# Autodesk Inventor assembly: result-flush
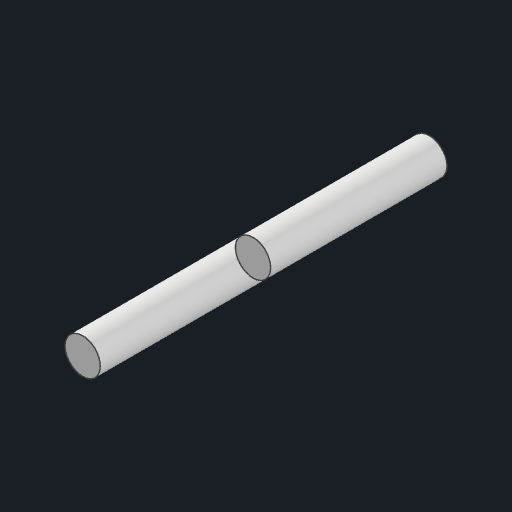
[picture p0: Inventor's stored thumbnail of the model, 512x512]
Saved by Autodesk Inventor 2026.1 (Build 301233000, 233)
## iProperties
Created: 2026-10-30
Part Number: result-flush
Document SubType Name: Assembly
Designer: david
Author: anony
## Documents named in this file (2)
- C:\Users\anony\OneDrive\Desktop\AI Projects\CAD Convert\corpus\generated\asmimate\result-flush.iam
- C:\Users\anony\OneDrive\Desktop\AI Projects\CAD Convert\corpus\generated\imate\flush.ipt
## Components (2 placed, 1 different names)
1. flush:1 — Flush:1
2. flush:2 — Flush:1
## Relationships (1: Flush 1)
- Flush:1 (1 mm): flush:1 ↔ flush:2
